# Autodesk Inventor assembly: RA_v1
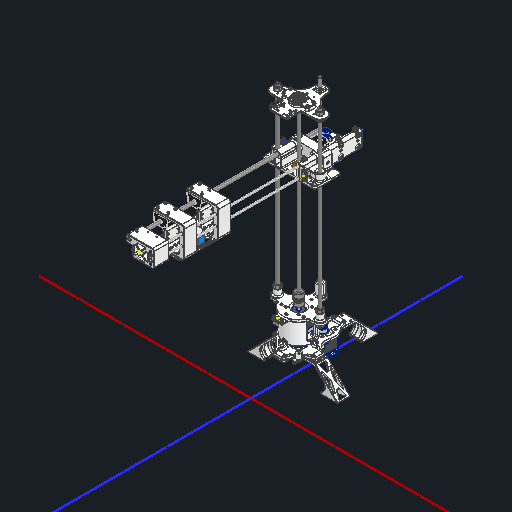
[picture p0: Inventor's stored thumbnail of the model, 512x512]
Saved by Autodesk Inventor 2026.2 (Build 302298010, 298A)
## iProperties
Created: 2026-04-25
Part Number: RA_v1
Document SubType Name: Assembly
Designer: work
Mass: 3600.07 g
Surface Area: 4552.63 cm^2
Volume: 1032.21 cm^3
Author: work
## Documents named in this file (50)
- C:\Users\khw\Desktop\ARD_v1\ARD_hardware\RA_Project\RA_v1.iam
- C:\Users\khw\Desktop\ARD_v1\ARD_hardware\RA_Project\48 Timing Belt Pulli.ipt
- C:\Users\khw\Desktop\ARD_v1\ARD_hardware\RA_Project\Y-axis - pulley support plate.ipt
- C:\Users\khw\Desktop\ARD_v1\ARD_hardware\RA_Project\Y-axis rotation plate.ipt
- C:\Users\khw\Desktop\ARD_v1\ARD_hardware\RA_Project\NEMA17.ipt
- C:\Users\khw\Desktop\ARD_v1\ARD_hardware\RA_Project\VL53L0X.ipt
- C:\Users\khw\Desktop\ARD_v1\ARD_hardware\RA_Project\X-axis fixing plate.ipt
- C:\Users\khw\Desktop\ARD_v1\ARD_hardware\RA_Project\JIS B 1521 - 625 5x16x5x1.73.ipt
- C:\Users\khw\Desktop\ARD_v1\ARD_hardware\RA_Project\5pi pin.ipt
- C:\Users\khw\Desktop\ARD_v1\ARD_hardware\RA_Project\X-axis disc support.ipt
- C:\Users\khw\Desktop\ARD_v1\ARD_hardware\RA_Project\T8linear shaft.ipt
- C:\Users\khw\Desktop\ARD_v1\ARD_hardware\RA_Project\T8Screws.ipt
- C:\Users\khw\Desktop\ARD_v1\ARD_hardware\RA_Project\8T_ScrewShaft.ipt
- C:\Users\khw\Desktop\ARD_v1\ARD_hardware\RA_Project\T8_BellowsCoulping.ipt
- C:\Users\khw\Desktop\ARD_v1\ARD_hardware\RA_Project\Y-axis End Leveler Mount.ipt
- C:\Users\khw\Desktop\ARD_v1\ARD_hardware\RA_Project\Y-axis end.ipt
- C:\Users\khw\Desktop\ARD_v1\ARD_hardware\RA_Project\Y-axis fixture.ipt
- C:\Users\khw\Desktop\ARD_v1\ARD_hardware\RA_Project\Y-axis Support fixing.ipt
- C:\Users\khw\Desktop\ARD_v1\ARD_hardware\RA_Project\T8_LeadNut.ipt
- C:\Users\khw\Desktop\ARD_v1\ARD_hardware\RA_Project\LeadWay.ipt
- C:\Users\khw\Desktop\ARD_v1\ARD_hardware\RA_Project\LimitedSwitch.ipt
- C:\Users\khw\Desktop\ARD_v1\ARD_hardware\RA_Project\24 Timing Belt Pulli.ipt
- C:\Users\khw\Desktop\ARD_v1\ARD_hardware\RA_Project\Al shaft 5pi-500mm.ipt
- C:\Users\khw\Desktop\ARD_v1\ARD_hardware\RA_Project\z-axis bearing puller support.ipt
- C:\Users\khw\Desktop\ARD_v1\ARD_hardware\RA_Project\end of the z-axis.ipt
- C:\Users\khw\Desktop\ARD_v1\ARD_hardware\RA_Project\KS B 1003 - M 3 x 16.ipt
- C:\Users\khw\Desktop\ARD_v1\ARD_hardware\RA_Project\KS B 1003 - M 2 x 10.ipt
- C:\Users\khw\Desktop\ARD_v1\ARD_hardware\RA_Project\JIS B 1521 - 623 3x10x4x0.630.ipt
- C:\Users\khw\Documents\Inventor\Content Center Files\R2026\ko-KR\KS B 1003\KS B 1003 - M 3 x 5.ipt
- C:\Users\khw\Desktop\ARD_v1\ARD_hardware\RA_Project\KS B 1003 - M 3 x 12.ipt
- C:\Users\khw\Documents\Inventor\Content Center Files\R2026\ko-KR\KS B 1003\KS B 1003 - M 2.5 x 4.ipt
- C:\Users\khw\Desktop\ARD_v1\ARD_hardware\RA_Project\KS B 1028 - M2.5x5(1).ipt
- C:\Users\khw\Desktop\ARD_v1\ARD_hardware\RA_Project\KS B 1028 - M3x5(1).ipt
- C:\Users\khw\Desktop\ARD_v1\ARD_hardware\RA_Project\KS B 1012 - C M8C.ipt
- C:\Users\khw\Desktop\ARD_v1\ARD_hardware\RA_Project\KS B 1003 - M 4 x 16.ipt
- C:\Users\khw\Desktop\ARD_v1\ARD_hardware\RA_Project\MPU-6050.ipt
- C:\Users\khw\Desktop\ARD_v1\ARD_hardware\RA_Project\Z-axis mover parts\Z-axis mover 2.ipt
- C:\Users\khw\Desktop\ARD_v1\ARD_hardware\RA_Project\Z-axis mover parts\Z-axis mover 1.ipt
- C:\Users\khw\Desktop\ARD_v1\ARD_hardware\RA_Project\JIS B 1521 - 608 8x22x7x3.3.ipt
- C:\Users\khw\Desktop\ARD_v1\ARD_hardware\RA_Project\KS B 1003 - M 1.6 x 2.5.ipt
- C:\Users\khw\Desktop\ARD_v1\ARD_hardware\RA_Project\Head\head stator.ipt
- C:\Users\khw\Desktop\ARD_v1\ARD_hardware\RA_Project\Head\GT2 Timing Belt Fixation.ipt
- C:\Users\khw\Desktop\ARD_v1\ARD_hardware\RA_Project\Head\Head connection and motor stator.ipt
- C:\Users\khw\Desktop\ARD_v1\ARD_hardware\RA_Project\28BJY-48.ipt
- C:\Users\khw\Desktop\ARD_v1\ARD_hardware\PneumaticGripper_v1\PneumaticGripper_v1.1.iam
- C:\Users\khw\Desktop\ARD_v1\ARD_hardware\RA_Project\RA_v1\AIP\FEA\fg7rvhdmo.fins
- C:\Users\khw\Desktop\ARD_v1\ARD_hardware\RA_Project\RA_v1\AIP\FEA\fg7rvhdnk.fsat
- C:\Users\khw\Desktop\ARD_v1\ARD_hardware\RA_Project\RA_v1\AIP\FEA\fg7rvhdnk.ftes
- C:\Users\khw\Desktop\ARD_v1\ARD_hardware\RA_Project\RA_v1\AIP\FEA\fg7rvhdnk.fwiz
- C:\Users\khw\Desktop\ARD_v1\ARD_hardware\RA_Project\RA_v1\AIP\FEA\fg7rvheu8.fmsh
## Components (166 placed, 44 different names)
1. 48 Timing Belt Pulli:1 — 메이트:1, 메이트:2, 메이트:17, 플러쉬:1, 메이트:18, 회전:1
2. Y-axis - pulley support plate:1 — 메이트:1, 메이트:2, 메이트:5, 메이트:6, 메이트:7, 각도:2, 회전:16, 회전:17, 회전:18, 회전:19
3. Y-axis rotation plate:1 — 메이트:3, 메이트:4, 메이트:5, 메이트:6, 메이트:7, 메이트:8, 메이트:9, 메이트:10, 메이트:32, 메이트:33, 메이트:34, 플러쉬:2, 메이트:35, 플러쉬:3, 삽입:1, 삽입:2, 삽입:3, 삽입:4, 삽입:5, 삽입:6, 삽입:7, 삽입:8, 삽입:9, 삽입:10, 회전:12, 회전:14, 메이트:104, 메이트:106, 삽입:43, 삽입:44
4. NEMA17:1 — 메이트:3, 메이트:4, 메이트:36, 메이트:37, 각도:2
5. VL53L0X:1 — 메이트:8, 메이트:9, 메이트:10, 삽입:11, 삽입:12
6. X-axis fixing plate:1 — 메이트:11, 메이트:12, 메이트:13, 메이트:14, 메이트:15, 메이트:22, 메이트:29, 메이트:30, 각도:1, 메이트:45, 메이트:46, 삽입:13, 삽입:14, 삽입:15, 삽입:16, 삽입:17, 삽입:18, 삽입:19, 삽입:20, 삽입:21, 삽입:22, 삽입:23, 삽입:24, 메이트:135, 메이트:136, 메이트:137, 메이트:138
7. NEMA17:2 — 메이트:11, 메이트:12, 메이트:13, 메이트:63, 플러쉬:4, 각도:9
8. 5pi pin:1 — 메이트:16, 메이트:17, 플러쉬:1, 메이트:44
9. X-axis disc support:1 — 메이트:47, 메이트:135, 메이트:136
10. X-axis disc support:3 — 메이트:48, 메이트:137, 메이트:138
11. X-axis disc support:4 — 메이트:22, 메이트:29, 메이트:30
12. T8linear shaft:1 — 메이트:32, 메이트:33, 메이트:40, 메이트:57
13. T8Screws:1 — 메이트:34, 플러쉬:2, 메이트:42, 메이트:87, 메이트:105
14. T8Screws:2 — 메이트:35, 플러쉬:3, 메이트:103
15. 8T_ScrewShaft:1 — 메이트:102, 메이트:109, 플러쉬:13, 메이트:112
16. T8_BellowsCoulping:1 — 메이트:36, 메이트:37, 메이트:79, 강체:6, 강체:7, 메이트:102, 메이트:112, 메이트:139
17. Y-axis End Leveler Mount:1 — 메이트:52, 메이트:53, 각도:3, 삽입:39, 삽입:40, 삽입:41, 삽입:42
18. Y-axis end:1 — 메이트:54, 메이트:55, 메이트:56, 회전:20, 회전:21
19. Y-axis fixture:1 — 메이트:44, 메이트:45, 메이트:46, 메이트:47, 메이트:48, 메이트:54, 메이트:55, 메이트:56
20. Y-axis Support fixing:1 — 메이트:40, 메이트:42, 메이트:52, 메이트:53, 각도:3, 메이트:61, 메이트:62, 각도:4, 회전:6, 회전:7, 회전:8, 회전:9, 회전:10, 플러쉬:13, 원통형:1, 메이트:111
21. T8_LeadNut:1 — 메이트:79, 메이트:89, 메이트:90, 메이트:109
22. LeadWay:1 — 메이트:57, 메이트:91, 메이트:92
23. LimitedSwitch:1 — 메이트:61, 메이트:62, 각도:4, 삽입:69, 삽입:70
24. 24 Timing Belt Pulli:1 — 메이트:63, 플러쉬:4, 회전:1, 강체:2, 강체:3
25. T8linear shaft:2 — 메이트:96, 플러쉬:11, 메이트:108
26. NEMA17:3 — 메이트:71, 플러쉬:6, 각도:7, 메이트:110, 각도:9
27. 24 Timing Belt Pulli:2 — 메이트:71, 플러쉬:6, 회전:3, 강체:4, 강체:5, 메이트:98
28. Z-axis mover 2:1 — 메이트:84, 메이트:85, 메이트:86, 메이트:87, 메이트:93, 메이트:95, 메이트:107, 삽입:51, 삽입:52, 삽입:53, 삽입:54, 삽입:55, 삽입:56, 삽입:57, 삽입:58, 삽입:59, 삽입:60, 삽입:61, 삽입:62, 각도:8
29. Z-axis mover 1:1 — 메이트:84, 메이트:85, 메이트:86, 메이트:89, 메이트:90, 메이트:91, 메이트:92, 메이트:96, 메이트:97, 메이트:98, 각도:7, 메이트:99, 메이트:100, 메이트:101, 메이트:108, 플러쉬:12, 메이트:110, 삽입:45, 삽입:46, 삽입:47, 삽입:48, 삽입:49, 삽입:50, 메이트:139
30. MPU-6050:3 — 메이트:99, 메이트:100, 메이트:101, 삽입:65, 삽입:66
31. head stator:1 — 메이트:113, 메이트:114, 메이트:115, 메이트:116, 메이트:117, 메이트:118, 메이트:119, 메이트:120, 메이트:121, 메이트:122, 메이트:123, 삽입:75, 삽입:76, 삽입:77, 삽입:78, 메이트:142, 메이트:143, 메이트:144, 각도:10
32. GT2 Timing Belt Fixation:1 — 메이트:115, 메이트:116, 메이트:117, 삽입:71, 삽입:72
33. GT2 Timing Belt Fixation:2 — 메이트:118, 메이트:119, 메이트:120, 삽입:73, 삽입:74
34. LeadWay:2 — 메이트:121, 메이트:122, 메이트:123
35. head stator:2 — 메이트:133, 메이트:134, 메이트:140, 메이트:141
36. GT2 Timing Belt Fixation:3
37. GT2 Timing Belt Fixation:4
38. LeadWay:3
39. Head connection and motor stator:1 — 메이트:140, 메이트:141, 메이트:142, 메이트:143, 메이트:144, 메이트:145, 메이트:146, 메이트:147, 삽입:87, 삽입:88, 삽입:89, 삽입:90, 삽입:91, 삽입:92, 삽입:93, 삽입:94, 삽입:95, 삽입:96, 삽입:97, 삽입:98, 삽입:99, 삽입:100, 삽입:101, 삽입:102, 삽입:103, 삽입:104
40. 28BJY-48:1 — 메이트:145, 메이트:146, 메이트:147, 메이트:148, 메이트:149
41. KS B 1003 - 미터 M 3 x 5:80 — 삽입:87
42. KS B 1003 - 미터 M 3 x 5:81 — 삽입:88
43. KS B 1003 - 미터 M 3 x 5:82 — 삽입:89
44. KS B 1003 - 미터 M 3 x 5:83 — 삽입:90
45. KS B 1003 - 미터 M 3 x 5:84 — 삽입:91
46. KS B 1003 - 미터 M 3 x 5:85 — 삽입:92
47. KS B 1003 - 미터 M 3 x 5:86 — 삽입:93
48. KS B 1003 - 미터 M 3 x 5:87 — 삽입:94
49. KS B 1003 - 미터 M 3 x 5:88 — 삽입:95
50. KS B 1003 - 미터 M 3 x 5:89 — 삽입:96
51. KS B 1003 - 미터 M 3 x 5:90 — 삽입:97
52. KS B 1003 - 미터 M 3 x 5:91 — 삽입:98
53. KS B 1003 - 미터 M 3 x 5:92 — 삽입:99
54. KS B 1003 - 미터 M 3 x 5:93 — 삽입:100
55. KS B 1003 - 미터 M 3 x 5:94 — 삽입:101
56. KS B 1003 - 미터 M 3 x 5:95 — 삽입:102
57. KS B 1003 - 미터 M 3 x 5:96 — 삽입:103
58. KS B 1003 - 미터 M 3 x 5:97 — 삽입:104
59. PneumaticGripper_v1.1:1 [sub-assembly] — 메이트:148, 메이트:149, 각도:10
60. JIS B 1521 - 625 5x16x5x1.73:1 — 메이트:14, 메이트:15, 메이트:16, 메이트:18
61. KS B 1003 - 미터 M 3 x 5:76
62. KS B 1003 - 미터 M 3 x 5:77
63. KS B 1003 - 미터 M 3 x 5:78
64. KS B 1003 - 미터 M 3 x 5:79
65. KS B 1003 - 미터 M 3 x 5:72
66. KS B 1003 - 미터 M 3 x 5:73
67. KS B 1003 - 미터 M 3 x 5:74
68. KS B 1003 - 미터 M 3 x 5:75
69. KS B 1003 - 미터 M 3 x 5:68 — 삽입:75
70. KS B 1003 - 미터 M 3 x 5:69 — 삽입:76
71. KS B 1003 - 미터 M 3 x 5:70 — 삽입:77
72. KS B 1003 - 미터 M 3 x 5:71 — 삽입:78
73. KS B 1003 - 미터 M 3 x 5:64 — 삽입:71
74. KS B 1003 - 미터 M 3 x 5:65 — 삽입:72
75. KS B 1003 - 미터 M 3 x 5:66 — 삽입:73
76. KS B 1003 - 미터 M 3 x 5:67 — 삽입:74
77. JIS B 1521 - 608 8x22x7x3.3:1 — 원통형:1, 메이트:111
78. KS B 1003 - 미터 M 3 x 5:44 — 삽입:43
79. KS B 1003 - 미터 M 3 x 5:45 — 삽입:44
80. KS B 1003 - 미터 M 3 x 5:46 — 삽입:45
81. KS B 1003 - 미터 M 3 x 5:47 — 삽입:46
82. KS B 1003 - 미터 M 3 x 5:48 — 삽입:47
83. KS B 1003 - 미터 M 3 x 5:49 — 삽입:48
84. KS B 1003 - 미터 M 3 x 5:50 — 삽입:49
85. KS B 1003 - 미터 M 3 x 5:51 — 삽입:50
86. KS B 1003 - 미터 M 3 x 5:52 — 삽입:51
87. KS B 1003 - 미터 M 3 x 5:53 — 삽입:52
88. KS B 1003 - 미터 M 3 x 5:54 — 삽입:53
89. KS B 1003 - 미터 M 3 x 5:55 — 삽입:54
90. KS B 1003 - 미터 M 3 x 5:56 — 삽입:55
91. KS B 1003 - 미터 M 3 x 5:57 — 삽입:56
92. KS B 1003 - 미터 M 3 x 5:58 — 삽입:57
93. KS B 1003 - 미터 M 3 x 5:59 — 삽입:58
94. KS B 1003 - 미터 M 3 x 5:60 — 삽입:59
95. KS B 1003 - 미터 M 3 x 5:61 — 삽입:60
96. KS B 1003 - 미터 M 3 x 5:62 — 삽입:61
97. KS B 1003 - 미터 M 3 x 5:63 — 삽입:62
98. KS B 1003 - 미터 M 2.5 x 4:3 — 삽입:63
99. KS B 1003 - 미터 M 2.5 x 4:4 — 삽입:64
100. KS B 1003 - 미터 M 2.5 x 4:5 — 삽입:65
101. KS B 1003 - 미터 M 2.5 x 4:6 — 삽입:66
102. KS B 1003 - M 1.6 x 2.5:1 — 삽입:67
103. KS B 1003 - M 1.6 x 2.5:2 — 삽입:68
104. KS B 1003 - M 1.6 x 2.5:3 — 삽입:69
105. KS B 1003 - M 1.6 x 2.5:4 — 삽입:70
106. Al shaft 5pi-500mm:1 — 메이트:77, 메이트:97, 플러쉬:10, 플러쉬:12, 메이트:113, 메이트:134
107. Al shaft 5pi-500mm:2 — 메이트:78, 플러쉬:9, 메이트:107, 메이트:114, 메이트:133
108. z-axis bearing puller support:1 — 메이트:74, 메이트:75, 메이트:76, 회전:1, 회전:2, 회전:3
109. end of the z-axis:1 — 메이트:74, 메이트:75, 메이트:76, 회전:4, 메이트:77, 메이트:78, 플러쉬:9, 메이트:82, 각도:6, 메이트:83, 회전:15, 플러쉬:10, 플러쉬:11
110. KS B 1003 - M 3 x 16:1 — 회전:1
111. KS B 1003 - M 2 x 10:1 — 회전:2
112. KS B 1003 - M 2 x 10:2 — 회전:3
113. JIS B 1521 - 623 3x10x4x0.630:1 — 회전:4, 회전:5, 회전:3, 회전:4
114. JIS B 1521 - 623 3x10x4x0.630:2 — 회전:5, 회전:4
115. VL53L0X:2 — 메이트:93, 메이트:95, 삽입:63, 삽입:64, 각도:8
116. LimitedSwitch:2 — 메이트:82, 각도:6, 메이트:83, 삽입:67, 삽입:68
117. KS B 1003 - M 3 x 12:1 — 삽입:1
118. KS B 1003 - 미터 M 3 x 5:1 — 삽입:2
119. KS B 1003 - 미터 M 3 x 5:2 — 삽입:3
120. KS B 1003 - 미터 M 3 x 5:3 — 삽입:4
121. KS B 1003 - 미터 M 3 x 5:4 — 삽입:5
122. KS B 1003 - 미터 M 3 x 5:5 — 삽입:6
123. KS B 1003 - 미터 M 3 x 5:6 — 삽입:7
124. KS B 1003 - 미터 M 3 x 5:7 — 삽입:8
125. KS B 1003 - 미터 M 3 x 5:8 — 삽입:9
126. KS B 1003 - 미터 M 3 x 5:9 — 삽입:10
127. KS B 1003 - 미터 M 2.5 x 4:1 — 삽입:11
128. KS B 1003 - 미터 M 2.5 x 4:2 — 삽입:12
129. KS B 1003 - 미터 M 3 x 5:10 — 삽입:13
130. KS B 1003 - 미터 M 3 x 5:11 — 삽입:14
131. KS B 1003 - 미터 M 3 x 5:12 — 삽입:15
132. KS B 1003 - 미터 M 3 x 5:13 — 삽입:16
133. KS B 1003 - 미터 M 3 x 5:14 — 삽입:17
134. KS B 1003 - 미터 M 3 x 5:15 — 삽입:18
135. KS B 1003 - 미터 M 3 x 5:16 — 삽입:19
136. KS B 1003 - 미터 M 3 x 5:17 — 삽입:20
137. KS B 1003 - 미터 M 3 x 5:18 — 삽입:21
138. KS B 1003 - 미터 M 3 x 5:19 — 삽입:22
139. KS B 1003 - 미터 M 3 x 5:20 — 삽입:23
140. KS B 1003 - 미터 M 3 x 5:21 — 삽입:24
141. KS B 1003 - 미터 M 3 x 5:36 — 삽입:39
142. KS B 1003 - 미터 M 3 x 5:37 — 삽입:40
143. KS B 1003 - 미터 M 3 x 5:38 — 삽입:41
144. KS B 1003 - 미터 M 3 x 5:39 — 삽입:42
145. KS B 1028 - M2.5x5(1):4 — 강체:2
146. KS B 1028 - M2.5x5(1):5 — 강체:3
147. KS B 1028 - M2.5x5(1):6 — 강체:4
148. KS B 1028 - M2.5x5(1):7 — 강체:5
149. KS B 1028 - M3x5(1):1 — 강체:7
150. KS B 1028 - M3x5(1):2 — 강체:6
151. KS B 1003 - 미터 M 3 x 5:40 — 회전:6
152. KS B 1012 - C M8C:1 — 회전:7
153. KS B 1012 - C M8C:2 — 회전:10
154. KS B 1012 - C M8C:3 — 회전:9
155. KS B 1012 - C M8C:4 — 회전:8
156. KS B 1012 - C M8C:5 — 메이트:103, 메이트:104
157. KS B 1012 - C M8C:6 — 회전:12
158. KS B 1012 - C M8C:7 — 메이트:105, 메이트:106
159. KS B 1012 - C M8C:8 — 회전:14
160. KS B 1003 - 미터 M 3 x 5:41 — 회전:15
161. KS B 1003 - M 4 x 16:1 — 회전:16
162. KS B 1003 - M 4 x 16:2 — 회전:17
163. KS B 1003 - M 4 x 16:3 — 회전:18
164. KS B 1003 - M 4 x 16:4 — 회전:19
165. KS B 1003 - 미터 M 3 x 5:42 — 회전:21
166. KS B 1003 - 미터 M 3 x 5:43 — 회전:20
## Relationships (254: Mate 116, Insert 90, RevoluteJoint 19, Flush 10, Angle 9, WeldJoint 6, RelateRotation 3, CylindricalJoint 1)
- 메이트:1 [Mate]: 48 Timing Belt Pulli:1 ↔ Y-axis - pulley support plate:1
- 메이트:2 [Mate]: 48 Timing Belt Pulli:1 ↔ Y-axis - pulley support plate:1
- 메이트:3 [Mate]: Y-axis rotation plate:1 ↔ NEMA17:1
- 메이트:4 [Mate]: Y-axis rotation plate:1 ↔ NEMA17:1
- 메이트:5 [Mate]: Y-axis - pulley support plate:1 ↔ Y-axis rotation plate:1
- 메이트:6 [Mate]: Y-axis - pulley support plate:1 ↔ Y-axis rotation plate:1
- 메이트:7 [Mate]: Y-axis - pulley support plate:1 ↔ Y-axis rotation plate:1
- 메이트:8 [Mate]: Y-axis rotation plate:1 ↔ VL53L0X:1
- 메이트:9 [Mate]: Y-axis rotation plate:1 ↔ VL53L0X:1
- 메이트:10 [Mate]: Y-axis rotation plate:1 ↔ VL53L0X:1
- 메이트:11 [Mate]: X-axis fixing plate:1 ↔ NEMA17:2
- 메이트:12 [Mate]: X-axis fixing plate:1 ↔ NEMA17:2
- 메이트:13 [Mate]: X-axis fixing plate:1 ↔ NEMA17:2
- 메이트:14 [Mate]: X-axis fixing plate:1 ↔ JIS B 1521 - 625 5x16x5x1.73:1
- 메이트:15 [Mate]: X-axis fixing plate:1 ↔ JIS B 1521 - 625 5x16x5x1.73:1
- 메이트:16 [Mate]: 5pi pin:1 ↔ JIS B 1521 - 625 5x16x5x1.73:1
- 메이트:17 [Mate]: 48 Timing Belt Pulli:1 ↔ 5pi pin:1
- 플러쉬:1 [Flush]: 48 Timing Belt Pulli:1 ↔ 5pi pin:1
- 메이트:18 [Mate] (5 mm): 48 Timing Belt Pulli:1 ↔ JIS B 1521 - 625 5x16x5x1.73:1
- 메이트:22 [Mate]: X-axis fixing plate:1 ↔ X-axis disc support:4
- 메이트:29 [Mate]: X-axis fixing plate:1 ↔ X-axis disc support:4
- 메이트:30 [Mate]: X-axis fixing plate:1 ↔ X-axis disc support:4
- 각도:1 [Angle] (0 deg): X-axis fixing plate:1
- 메이트:32 [Mate]: Y-axis rotation plate:1 ↔ T8linear shaft:1
- 메이트:33 [Mate]: Y-axis rotation plate:1 ↔ T8linear shaft:1
- 메이트:34 [Mate]: Y-axis rotation plate:1 ↔ T8Screws:1
- 플러쉬:2 [Flush] (10 mm): Y-axis rotation plate:1 ↔ T8Screws:1
- 메이트:35 [Mate]: Y-axis rotation plate:1 ↔ T8Screws:2
- 플러쉬:3 [Flush] (10 mm): Y-axis rotation plate:1 ↔ T8Screws:2
- 메이트:36 [Mate]: NEMA17:1 ↔ T8_BellowsCoulping:1
- 메이트:37 [Mate] (10 mm): NEMA17:1 ↔ T8_BellowsCoulping:1
- 각도:2 [Angle] (0 deg): Y-axis - pulley support plate:1 ↔ NEMA17:1
- 메이트:40 [Mate]: T8linear shaft:1 ↔ Y-axis Support fixing:1
- 메이트:42 [Mate]: T8Screws:1 ↔ Y-axis Support fixing:1
- 메이트:44 [Mate]: 5pi pin:1 ↔ Y-axis fixture:1
- 메이트:45 [Mate]: X-axis fixing plate:1 ↔ Y-axis fixture:1
- 메이트:46 [Mate]: X-axis fixing plate:1 ↔ Y-axis fixture:1
- 메이트:47 [Mate]: X-axis disc support:1 ↔ Y-axis fixture:1
- 메이트:48 [Mate]: X-axis disc support:3 ↔ Y-axis fixture:1
- 메이트:52 [Mate]: Y-axis End Leveler Mount:1 ↔ Y-axis Support fixing:1
- 메이트:53 [Mate]: Y-axis End Leveler Mount:1 ↔ Y-axis Support fixing:1
- 각도:3 [Angle] (0 deg): Y-axis End Leveler Mount:1 ↔ Y-axis Support fixing:1
- 메이트:54 [Mate]: Y-axis end:1 ↔ Y-axis fixture:1
- 메이트:55 [Mate]: Y-axis end:1 ↔ Y-axis fixture:1
- 메이트:56 [Mate]: Y-axis end:1 ↔ Y-axis fixture:1
- 메이트:57 [Mate]: T8linear shaft:1 ↔ LeadWay:1
- 메이트:61 [Mate]: Y-axis Support fixing:1 ↔ LimitedSwitch:1
- 메이트:62 [Mate]: Y-axis Support fixing:1 ↔ LimitedSwitch:1
- 각도:4 [Angle] (0 deg): Y-axis Support fixing:1 ↔ LimitedSwitch:1
- 메이트:63 [Mate]: NEMA17:2 ↔ 24 Timing Belt Pulli:1
- 플러쉬:4 [Flush] (-2 mm): NEMA17:2 ↔ 24 Timing Belt Pulli:1
- 메이트:71 [Mate]: NEMA17:3 ↔ 24 Timing Belt Pulli:2
- 플러쉬:6 [Flush] (-3 mm): NEMA17:3 ↔ 24 Timing Belt Pulli:2
- 메이트:74 [Mate]: z-axis bearing puller support:1 ↔ end of the z-axis:1
- 메이트:75 [Mate]: z-axis bearing puller support:1 ↔ end of the z-axis:1
- 메이트:76 [Mate]: z-axis bearing puller support:1 ↔ end of the z-axis:1
- 회전:1 [RevoluteJoint]: z-axis bearing puller support:1 ↔ KS B 1003 - M 3 x 16:1
- 회전:2 [RevoluteJoint]: z-axis bearing puller support:1 ↔ KS B 1003 - M 2 x 10:1
- 회전:3 [RevoluteJoint]: z-axis bearing puller support:1 ↔ KS B 1003 - M 2 x 10:2
- 회전:4 [RevoluteJoint]: end of the z-axis:1 ↔ JIS B 1521 - 623 3x10x4x0.630:1
- 회전:5 [RevoluteJoint]: JIS B 1521 - 623 3x10x4x0.630:1 ↔ JIS B 1521 - 623 3x10x4x0.630:2
- 메이트:77 [Mate]: Al shaft 5pi-500mm:1 ↔ end of the z-axis:1
- 메이트:78 [Mate]: Al shaft 5pi-500mm:2 ↔ end of the z-axis:1
- 플러쉬:9 [Flush]: Al shaft 5pi-500mm:2 ↔ end of the z-axis:1
- 메이트:79 [Mate]: T8_BellowsCoulping:1 ↔ T8_LeadNut:1
- 회전:1 [RelateRotation] (0.25 ul): 48 Timing Belt Pulli:1 ↔ 24 Timing Belt Pulli:1
- 메이트:82 [Mate]: end of the z-axis:1 ↔ LimitedSwitch:2
- 각도:6 [Angle] (0 deg): end of the z-axis:1 ↔ LimitedSwitch:2
- 메이트:83 [Mate]: end of the z-axis:1 ↔ LimitedSwitch:2
- 회전:3 [RelateRotation] (1 ul): 24 Timing Belt Pulli:2 ↔ JIS B 1521 - 623 3x10x4x0.630:1
- 회전:4 [RelateRotation] (1 ul): JIS B 1521 - 623 3x10x4x0.630:1 ↔ JIS B 1521 - 623 3x10x4x0.630:2
- 삽입:1 [Insert]: Y-axis rotation plate:1 ↔ KS B 1003 - M 3 x 12:1
- 삽입:2 [Insert]: Y-axis rotation plate:1 ↔ KS B 1003 - 미터 M 3 x 5:1
- 삽입:3 [Insert]: Y-axis rotation plate:1 ↔ KS B 1003 - 미터 M 3 x 5:2
- 삽입:4 [Insert]: Y-axis rotation plate:1 ↔ KS B 1003 - 미터 M 3 x 5:3
- 삽입:5 [Insert]: Y-axis rotation plate:1 ↔ KS B 1003 - 미터 M 3 x 5:4
- 삽입:6 [Insert]: Y-axis rotation plate:1 ↔ KS B 1003 - 미터 M 3 x 5:5
- 삽입:7 [Insert]: Y-axis rotation plate:1 ↔ KS B 1003 - 미터 M 3 x 5:6
- 삽입:8 [Insert]: Y-axis rotation plate:1 ↔ KS B 1003 - 미터 M 3 x 5:7
- 삽입:9 [Insert]: Y-axis rotation plate:1 ↔ KS B 1003 - 미터 M 3 x 5:8
- 삽입:10 [Insert]: Y-axis rotation plate:1 ↔ KS B 1003 - 미터 M 3 x 5:9
- 삽입:11 [Insert]: VL53L0X:1 ↔ KS B 1003 - 미터 M 2.5 x 4:1
- 삽입:12 [Insert]: VL53L0X:1 ↔ KS B 1003 - 미터 M 2.5 x 4:2
- 삽입:13 [Insert]: X-axis fixing plate:1 ↔ KS B 1003 - 미터 M 3 x 5:10
- 삽입:14 [Insert]: X-axis fixing plate:1 ↔ KS B 1003 - 미터 M 3 x 5:11
- 삽입:15 [Insert]: X-axis fixing plate:1 ↔ KS B 1003 - 미터 M 3 x 5:12
- 삽입:16 [Insert]: X-axis fixing plate:1 ↔ KS B 1003 - 미터 M 3 x 5:13
- 삽입:17 [Insert]: X-axis fixing plate:1 ↔ KS B 1003 - 미터 M 3 x 5:14
- 삽입:18 [Insert]: X-axis fixing plate:1 ↔ KS B 1003 - 미터 M 3 x 5:15
- 삽입:19 [Insert]: X-axis fixing plate:1 ↔ KS B 1003 - 미터 M 3 x 5:16
- 삽입:20 [Insert]: X-axis fixing plate:1 ↔ KS B 1003 - 미터 M 3 x 5:17
- 삽입:21 [Insert]: X-axis fixing plate:1 ↔ KS B 1003 - 미터 M 3 x 5:18
- 삽입:22 [Insert]: X-axis fixing plate:1 ↔ KS B 1003 - 미터 M 3 x 5:19
- 삽입:23 [Insert]: X-axis fixing plate:1 ↔ KS B 1003 - 미터 M 3 x 5:20
- 삽입:24 [Insert]: X-axis fixing plate:1 ↔ KS B 1003 - 미터 M 3 x 5:21
- 삽입:39 [Insert]: Y-axis End Leveler Mount:1 ↔ KS B 1003 - 미터 M 3 x 5:36
- 삽입:40 [Insert]: Y-axis End Leveler Mount:1 ↔ KS B 1003 - 미터 M 3 x 5:37
- 삽입:41 [Insert]: Y-axis End Leveler Mount:1 ↔ KS B 1003 - 미터 M 3 x 5:38
- 삽입:42 [Insert]: Y-axis End Leveler Mount:1 ↔ KS B 1003 - 미터 M 3 x 5:39
- 강체:2 [WeldJoint]: 24 Timing Belt Pulli:1 ↔ KS B 1028 - M2.5x5(1):4
- 강체:3 [WeldJoint]: 24 Timing Belt Pulli:1 ↔ KS B 1028 - M2.5x5(1):5
- 강체:4 [WeldJoint]: 24 Timing Belt Pulli:2 ↔ KS B 1028 - M2.5x5(1):6
- 강체:5 [WeldJoint]: 24 Timing Belt Pulli:2 ↔ KS B 1028 - M2.5x5(1):7
- 강체:6 [WeldJoint]: T8_BellowsCoulping:1 ↔ KS B 1028 - M3x5(1):2
- 강체:7 [WeldJoint]: T8_BellowsCoulping:1 ↔ KS B 1028 - M3x5(1):1
- 회전:6 [RevoluteJoint]: Y-axis Support fixing:1 ↔ KS B 1003 - 미터 M 3 x 5:40
- 회전:7 [RevoluteJoint]: Y-axis Support fixing:1 ↔ KS B 1012 - C M8C:1
- 회전:8 [RevoluteJoint]: Y-axis Support fixing:1 ↔ KS B 1012 - C M8C:4
- 회전:9 [RevoluteJoint]: Y-axis Support fixing:1 ↔ KS B 1012 - C M8C:3
- 회전:10 [RevoluteJoint]: Y-axis Support fixing:1 ↔ KS B 1012 - C M8C:2
- 회전:12 [RevoluteJoint]: Y-axis rotation plate:1 ↔ KS B 1012 - C M8C:6
- 회전:14 [RevoluteJoint]: Y-axis rotation plate:1 ↔ KS B 1012 - C M8C:8
- 회전:15 [RevoluteJoint]: end of the z-axis:1 ↔ KS B 1003 - 미터 M 3 x 5:41
- 회전:16 [RevoluteJoint]: Y-axis - pulley support plate:1 ↔ KS B 1003 - M 4 x 16:1
- 회전:17 [RevoluteJoint]: Y-axis - pulley support plate:1 ↔ KS B 1003 - M 4 x 16:2
- 회전:18 [RevoluteJoint]: Y-axis - pulley support plate:1 ↔ KS B 1003 - M 4 x 16:3
- 회전:19 [RevoluteJoint]: Y-axis - pulley support plate:1 ↔ KS B 1003 - M 4 x 16:4
- 회전:20 [RevoluteJoint]: Y-axis end:1 ↔ KS B 1003 - 미터 M 3 x 5:43
- 회전:21 [RevoluteJoint]: Y-axis end:1 ↔ KS B 1003 - 미터 M 3 x 5:42
- 메이트:84 [Mate]: Z-axis mover 2:1 ↔ Z-axis mover 1:1
- 메이트:85 [Mate]: Z-axis mover 2:1 ↔ Z-axis mover 1:1
- 메이트:86 [Mate]: Z-axis mover 2:1 ↔ Z-axis mover 1:1
- 메이트:87 [Mate]: T8Screws:1 ↔ Z-axis mover 2:1
- 메이트:89 [Mate]: T8_LeadNut:1 ↔ Z-axis mover 1:1
- 메이트:90 [Mate]: T8_LeadNut:1 ↔ Z-axis mover 1:1
- 메이트:91 [Mate]: LeadWay:1 ↔ Z-axis mover 1:1
- 메이트:92 [Mate]: LeadWay:1 ↔ Z-axis mover 1:1
- 메이트:93 [Mate]: Z-axis mover 2:1 ↔ VL53L0X:2
- 메이트:95 [Mate]: Z-axis mover 2:1 ↔ VL53L0X:2
- 메이트:96 [Mate]: T8linear shaft:2 ↔ Z-axis mover 1:1
- 메이트:97 [Mate]: Z-axis mover 1:1 ↔ Al shaft 5pi-500mm:1
- 메이트:98 [Mate]: 24 Timing Belt Pulli:2 ↔ Z-axis mover 1:1
- 각도:7 [Angle] (0 deg): NEMA17:3 ↔ Z-axis mover 1:1
- 메이트:99 [Mate]: Z-axis mover 1:1 ↔ MPU-6050:3
- 메이트:100 [Mate]: Z-axis mover 1:1 ↔ MPU-6050:3
- 메이트:101 [Mate]: Z-axis mover 1:1 ↔ MPU-6050:3
- 메이트:102 [Mate]: 8T_ScrewShaft:1 ↔ T8_BellowsCoulping:1
- 플러쉬:10 [Flush]: Al shaft 5pi-500mm:1 ↔ end of the z-axis:1
- 플러쉬:11 [Flush]: T8linear shaft:2 ↔ end of the z-axis:1
- 메이트:103 [Mate]: T8Screws:2 ↔ KS B 1012 - C M8C:5
- 메이트:104 [Mate]: Y-axis rotation plate:1 ↔ KS B 1012 - C M8C:5
- 메이트:105 [Mate]: T8Screws:1 ↔ KS B 1012 - C M8C:7
- 메이트:106 [Mate]: Y-axis rotation plate:1 ↔ KS B 1012 - C M8C:7
- 메이트:107 [Mate]: Z-axis mover 2:1 ↔ Al shaft 5pi-500mm:2
- 메이트:108 [Mate]: T8linear shaft:2 ↔ Z-axis mover 1:1
- 플러쉬:12 [Flush] (-5 mm): Z-axis mover 1:1 ↔ Al shaft 5pi-500mm:1
- 메이트:109 [Mate]: 8T_ScrewShaft:1 ↔ T8_LeadNut:1
- 메이트:110 [Mate]: NEMA17:3 ↔ Z-axis mover 1:1
- 플러쉬:13 [Flush]: 8T_ScrewShaft:1 ↔ Y-axis Support fixing:1
- 원통형:1 [CylindricalJoint]: Y-axis Support fixing:1 ↔ JIS B 1521 - 608 8x22x7x3.3:1
- 메이트:111 [Mate]: Y-axis Support fixing:1 ↔ JIS B 1521 - 608 8x22x7x3.3:1
- 메이트:112 [Mate] (-10 mm): 8T_ScrewShaft:1 ↔ T8_BellowsCoulping:1
- 삽입:43 [Insert]: Y-axis rotation plate:1 ↔ KS B 1003 - 미터 M 3 x 5:44
- 삽입:44 [Insert]: Y-axis rotation plate:1 ↔ KS B 1003 - 미터 M 3 x 5:45
- 삽입:45 [Insert]: Z-axis mover 1:1 ↔ KS B 1003 - 미터 M 3 x 5:46
- 삽입:46 [Insert]: Z-axis mover 1:1 ↔ KS B 1003 - 미터 M 3 x 5:47
- 삽입:47 [Insert]: Z-axis mover 1:1 ↔ KS B 1003 - 미터 M 3 x 5:48
- 삽입:48 [Insert]: Z-axis mover 1:1 ↔ KS B 1003 - 미터 M 3 x 5:49
- 삽입:49 [Insert]: Z-axis mover 1:1 ↔ KS B 1003 - 미터 M 3 x 5:50
- 삽입:50 [Insert]: Z-axis mover 1:1 ↔ KS B 1003 - 미터 M 3 x 5:51
- 삽입:51 [Insert]: Z-axis mover 2:1 ↔ KS B 1003 - 미터 M 3 x 5:52
- 삽입:52 [Insert]: Z-axis mover 2:1 ↔ KS B 1003 - 미터 M 3 x 5:53
- 삽입:53 [Insert]: Z-axis mover 2:1 ↔ KS B 1003 - 미터 M 3 x 5:54
- 삽입:54 [Insert]: Z-axis mover 2:1 ↔ KS B 1003 - 미터 M 3 x 5:55
- 삽입:55 [Insert]: Z-axis mover 2:1 ↔ KS B 1003 - 미터 M 3 x 5:56
- 삽입:56 [Insert]: Z-axis mover 2:1 ↔ KS B 1003 - 미터 M 3 x 5:57
- 삽입:57 [Insert]: Z-axis mover 2:1 ↔ KS B 1003 - 미터 M 3 x 5:58
- 삽입:58 [Insert]: Z-axis mover 2:1 ↔ KS B 1003 - 미터 M 3 x 5:59
- 삽입:59 [Insert]: Z-axis mover 2:1 ↔ KS B 1003 - 미터 M 3 x 5:60
- 삽입:60 [Insert]: Z-axis mover 2:1 ↔ KS B 1003 - 미터 M 3 x 5:61
- 삽입:61 [Insert]: Z-axis mover 2:1 ↔ KS B 1003 - 미터 M 3 x 5:62
- 삽입:62 [Insert]: Z-axis mover 2:1 ↔ KS B 1003 - 미터 M 3 x 5:63
- 삽입:63 [Insert]: KS B 1003 - 미터 M 2.5 x 4:3 ↔ VL53L0X:2
- 삽입:64 [Insert]: KS B 1003 - 미터 M 2.5 x 4:4 ↔ VL53L0X:2
- 각도:8 [Angle] (0 deg): Z-axis mover 2:1 ↔ VL53L0X:2
- 삽입:65 [Insert]: MPU-6050:3 ↔ KS B 1003 - 미터 M 2.5 x 4:5
- 삽입:66 [Insert]: MPU-6050:3 ↔ KS B 1003 - 미터 M 2.5 x 4:6
- 삽입:67 [Insert]: KS B 1003 - M 1.6 x 2.5:1 ↔ LimitedSwitch:2
- 삽입:68 [Insert]: KS B 1003 - M 1.6 x 2.5:2 ↔ LimitedSwitch:2
- 삽입:69 [Insert]: LimitedSwitch:1 ↔ KS B 1003 - M 1.6 x 2.5:3
- 삽입:70 [Insert]: LimitedSwitch:1 ↔ KS B 1003 - M 1.6 x 2.5:4
- 메이트:113 [Mate]: head stator:1 ↔ Al shaft 5pi-500mm:1
- 메이트:114 [Mate]: head stator:1 ↔ Al shaft 5pi-500mm:2
- 메이트:115 [Mate]: head stator:1 ↔ GT2 Timing Belt Fixation:1
- 메이트:116 [Mate]: head stator:1 ↔ GT2 Timing Belt Fixation:1
- 메이트:117 [Mate]: head stator:1 ↔ GT2 Timing Belt Fixation:1
- 메이트:118 [Mate]: head stator:1 ↔ GT2 Timing Belt Fixation:2
- 메이트:119 [Mate]: head stator:1 ↔ GT2 Timing Belt Fixation:2
- 메이트:120 [Mate]: head stator:1 ↔ GT2 Timing Belt Fixation:2
- 삽입:71 [Insert]: GT2 Timing Belt Fixation:1 ↔ KS B 1003 - 미터 M 3 x 5:64
- 삽입:72 [Insert]: GT2 Timing Belt Fixation:1 ↔ KS B 1003 - 미터 M 3 x 5:65
- 삽입:73 [Insert]: GT2 Timing Belt Fixation:2 ↔ KS B 1003 - 미터 M 3 x 5:66
- 삽입:74 [Insert]: GT2 Timing Belt Fixation:2 ↔ KS B 1003 - 미터 M 3 x 5:67
- 메이트:121 [Mate]: head stator:1 ↔ LeadWay:2
- 메이트:122 [Mate]: head stator:1 ↔ LeadWay:2
- 메이트:123 [Mate]: head stator:1 ↔ LeadWay:2
- 삽입:75 [Insert]: head stator:1 ↔ KS B 1003 - 미터 M 3 x 5:68
- 삽입:76 [Insert]: head stator:1 ↔ KS B 1003 - 미터 M 3 x 5:69
- 삽입:77 [Insert]: head stator:1 ↔ KS B 1003 - 미터 M 3 x 5:70
- 삽입:78 [Insert]: head stator:1 ↔ KS B 1003 - 미터 M 3 x 5:71
- [Mate]: head stator:2 ↔ GT2 Timing Belt Fixation:3
- [Mate]: head stator:2 ↔ GT2 Timing Belt Fixation:3
- [Mate]: head stator:2 ↔ GT2 Timing Belt Fixation:3
- [Mate]: head stator:2 ↔ GT2 Timing Belt Fixation:4
- [Mate]: head stator:2 ↔ GT2 Timing Belt Fixation:4
- [Mate]: head stator:2 ↔ GT2 Timing Belt Fixation:4
- [Insert]: GT2 Timing Belt Fixation:3 ↔ KS B 1003 - 미터 M 3 x 5:72
- [Insert]: GT2 Timing Belt Fixation:3 ↔ KS B 1003 - 미터 M 3 x 5:73
- [Insert]: GT2 Timing Belt Fixation:4 ↔ KS B 1003 - 미터 M 3 x 5:74
- [Insert]: GT2 Timing Belt Fixation:4 ↔ KS B 1003 - 미터 M 3 x 5:75
- [Mate]: head stator:2 ↔ LeadWay:3
- [Mate]: head stator:2 ↔ LeadWay:3
- [Mate]: head stator:2 ↔ LeadWay:3
- [Insert]: head stator:2 ↔ KS B 1003 - 미터 M 3 x 5:76
- [Insert]: head stator:2 ↔ KS B 1003 - 미터 M 3 x 5:77
- [Insert]: head stator:2 ↔ KS B 1003 - 미터 M 3 x 5:78
- [Insert]: head stator:2 ↔ KS B 1003 - 미터 M 3 x 5:79
- 메이트:133 [Mate]: head stator:2 ↔ Al shaft 5pi-500mm:2
- 메이트:134 [Mate]: head stator:2 ↔ Al shaft 5pi-500mm:1
- 메이트:135 [Mate]: X-axis fixing plate:1 ↔ X-axis disc support:1
- 메이트:136 [Mate]: X-axis fixing plate:1 ↔ X-axis disc support:1
- 메이트:137 [Mate]: X-axis fixing plate:1 ↔ X-axis disc support:3
- 메이트:138 [Mate]: X-axis fixing plate:1 ↔ X-axis disc support:3
- 각도:9 [Angle] (0 deg): NEMA17:2 ↔ NEMA17:3
- 메이트:139 [Mate] (250 mm): T8_BellowsCoulping:1 ↔ Z-axis mover 1:1
- 메이트:140 [Mate]: head stator:2 ↔ Head connection and motor stator:1
- 메이트:141 [Mate]: head stator:2 ↔ Head connection and motor stator:1
- 메이트:142 [Mate]: head stator:1 ↔ Head connection and motor stator:1
- 메이트:143 [Mate]: head stator:1 ↔ Head connection and motor stator:1
- 메이트:144 [Mate]: head stator:1 ↔ Head connection and motor stator:1
- 메이트:145 [Mate]: Head connection and motor stator:1 ↔ 28BJY-48:1
- 메이트:146 [Mate]: Head connection and motor stator:1 ↔ 28BJY-48:1
- 메이트:147 [Mate]: Head connection and motor stator:1 ↔ 28BJY-48:1
- 삽입:87 [Insert]: Head connection and motor stator:1 ↔ KS B 1003 - 미터 M 3 x 5:80
- 삽입:88 [Insert]: Head connection and motor stator:1 ↔ KS B 1003 - 미터 M 3 x 5:81
- 삽입:89 [Insert]: Head connection and motor stator:1 ↔ KS B 1003 - 미터 M 3 x 5:82
- 삽입:90 [Insert]: Head connection and motor stator:1 ↔ KS B 1003 - 미터 M 3 x 5:83
- 삽입:91 [Insert]: Head connection and motor stator:1 ↔ KS B 1003 - 미터 M 3 x 5:84
- 삽입:92 [Insert]: Head connection and motor stator:1 ↔ KS B 1003 - 미터 M 3 x 5:85
- 삽입:93 [Insert]: Head connection and motor stator:1 ↔ KS B 1003 - 미터 M 3 x 5:86
- 삽입:94 [Insert]: Head connection and motor stator:1 ↔ KS B 1003 - 미터 M 3 x 5:87
- 삽입:95 [Insert]: Head connection and motor stator:1 ↔ KS B 1003 - 미터 M 3 x 5:88
- 삽입:96 [Insert]: Head connection and motor stator:1 ↔ KS B 1003 - 미터 M 3 x 5:89
- 삽입:97 [Insert]: Head connection and motor stator:1 ↔ KS B 1003 - 미터 M 3 x 5:90
- 삽입:98 [Insert]: Head connection and motor stator:1 ↔ KS B 1003 - 미터 M 3 x 5:91
- 삽입:99 [Insert]: Head connection and motor stator:1 ↔ KS B 1003 - 미터 M 3 x 5:92
- 삽입:100 [Insert]: Head connection and motor stator:1 ↔ KS B 1003 - 미터 M 3 x 5:93
- 삽입:101 [Insert]: Head connection and motor stator:1 ↔ KS B 1003 - 미터 M 3 x 5:94
- 삽입:102 [Insert]: Head connection and motor stator:1 ↔ KS B 1003 - 미터 M 3 x 5:95
- 삽입:103 [Insert]: Head connection and motor stator:1 ↔ KS B 1003 - 미터 M 3 x 5:96
- 삽입:104 [Insert]: Head connection and motor stator:1 ↔ KS B 1003 - 미터 M 3 x 5:97
- 메이트:148 [Mate]: 28BJY-48:1 ↔ PneumaticGripper_v1.1:1
- 메이트:149 [Mate] (-5 mm): 28BJY-48:1 ↔ PneumaticGripper_v1.1:1
- 각도:10 [Angle] (0 deg): head stator:1 ↔ PneumaticGripper_v1.1:1
## Named parameters: d444_d411 = 0 mm, d445_d412 = 0 mm, d446_d413 = 0 mm, d447_d414 = 0 mm, d448_d415 = 0 mm, d449_d416 = 0 mm, d450_d417 = 0 mm, d451_d418 = 0 mm, d452_d419 = 0 mm, d453_d420 = 0 mm, d454_d421 = 0 mm, d455_d422 = 0 mm, d456_d423 = 0 mm, d457_d424 = 0 mm, d458_d425 = 0 mm, d459_d426 = 0 mm, d460_d427 = 0 mm, d461_d428 = 0 mm, d462_d429 = 0 mm, d463_d430 = 0 mm, d464_d431 = 0 mm, d465_d432 = 0 mm, d466_d433 = 0 mm, d467_d434 = 0 mm, d468_d435 = 0 mm, d469_d436 = 0 mm, d470_d437 = 0 mm, d471_d438 = 0 mm, d472_d439 = 0 mm, d473_d440 = 0 mm, d474_d441 = 0 mm, d475_d442 = 0 mm, d476_d443 = 0 mm, sa_0 = 981
note: some values were not read from the file. Shown as the stored number, unit unknown: "sa_0".
